# Autodesk Inventor assembly: MM0948AN140_G22_001
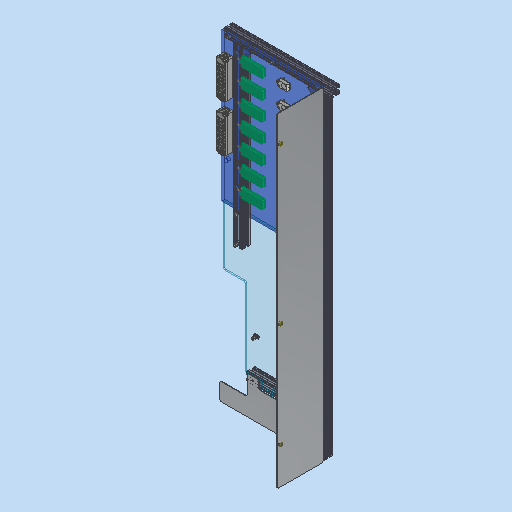
[picture p0: Inventor's stored thumbnail of the model, 512x512]
Saved by Autodesk Inventor 2023.3 (Build 273359000, 359)
## iProperties
Created: 2023-03-23
Part Number: MM0948AN140_G22_001
Description: =<RBPARTNOTITLE2>
Document SubType Name: Assembly
Designer: FH/Wi
Mass: 9319.01 g
Surface Area: 19971.7 cm^2
Volume: 3785.04 cm^3
Density: 2.46206 g/cm^3
AnP_Kategorie: 99
AnP_Material: =<Material>
AnP_TemplVers: 20200821
RBDOCUMENTTYPE: DRF
RBDOCUMENTVERSION: 00
RBDRAWINGMAINSCALE: 1:1
RBDRAWINGMISSINGSPEC: --
RBDRAWINGVOLUME: --
RBDSV1: 0850
RBGBEDGESIN1: +0,5
RBGBEDGESIN2: +0,2
RBGBEDGESOUT1: -0,3
RBGBEDGESOUT2: -0,1
RBMATERIAL: =<Material>
RBMATMEETS: --
RBMATNO: =<Part Number>
RBPARTMADEOF: --
RBPARTNO: SIEHE MNR
RBPARTNOTITLE1: protection XTS
RBPARTNOTITLE2: Eingriffschutz XTS
RBPARTSAFETYINDICATOR: --
RBSURFACE: --
RBSURFACE2: --
RBZEDGESNORM: ISO13715:2002-06
RBZGENDIMCLASS: m
RBZGENDIMNORM: ISO 2768-1:1989-11
RBZGENGEOCLASS: H
RBZGENGEONORM: ISO 2768-2:1989-11
RBZSURFACENORM: ISO13D2:2002-02
RBZTOLERANCENORM: ISO 14405-1:2010-12
Author: FH/Wi
Keywords: =<RBPARTMADEOF>
Comments: =<RBSURFACE2>
Revision Number: 01
## Documents named in this file (25)
- C:\Users\rea9an\Documents\Inventor\TCAI2412_te1910_EM\AS00000959.iam
- C:\Users\rea9an\Documents\Inventor\TCAI2412_te1910_EM\PT00004671.ipt
- C:\Users\rea9an\Documents\Inventor\TCAI2412_te1910_EM\PT00004404.ipt
- C:\Users\rea9an\Documents\Inventor\TCAI2412_te1910_EM\PT00004672.ipt
- C:\Users\rea9an\Documents\Inventor\TCAI2412_te1910_EM\PT00004327.ipt
- C:\Users\rea9an\Documents\Inventor\TCAI2412_te1910_EM\PT00004867.ipt
- C:\Users\rea9an\Documents\Inventor\TCAI2412_te1910_EM\PT00004683.ipt
- C:\Users\rea9an\Documents\Inventor\TCAI2412_te1910_EM\PT00004684.ipt
- C:\Users\rea9an\Documents\Inventor\TCAI2412_te1910_EM\PT00004924.ipt
- C:\Users\rea9an\Documents\Inventor\TCAI2412_te1910_EM\PT00004885.ipt
- C:\Users\rea9an\Documents\Inventor\TCAI2412_te1910_EM\PT00004887.ipt
- C:\Users\rea9an\Documents\Inventor\TCAI2412_te1910_EM\PT00004328.ipt
- C:\Users\rea9an\Documents\Inventor\TCAI2412_te1910_EM\PT00004401.ipt
- C:\Users\rea9an\Documents\Inventor\TCAI2412_te1910_EM\PT00004662.ipt
- C:\Users\rea9an\Documents\Inventor\TCAI2412_te1910_EM\PT00004294.ipt
- C:\Users\rea9an\Documents\Inventor\TCAI2412_te1910_EM\PT00004875.ipt
- C:\Users\rea9an\Documents\Inventor\TCAI2412_te1910_EM\PT00004298.ipt
- C:\Users\rea9an\Documents\Inventor\TCAI2412_te1910_EM\PT00004291.ipt
- C:\Users\rea9an\Documents\Inventor\TCAI2412_te1910_EM\PT00004886.ipt
- C:\Users\rea9an\Documents\Inventor\TCAI2412_te1910_EM\PT00004366.ipt
- C:\Users\rea9an\Documents\Inventor\TCAI2412_te1910_EM\PT00004859.ipt
- C:\Users\rea9an\Documents\Inventor\TCAI2412_te1910_EM\PT00004679.ipt
- C:\Users\rea9an\Documents\Inventor\TCAI2412_te1910_EM\PT00004716.ipt
- C:\Users\rea9an\Documents\Inventor\TCAI2412_te1910_EM\PT00004785.ipt
- C:\Users\rea9an\Documents\Inventor\TCAI2412_te1910_EM\PT00004783.ipt
## Components (102 placed, 24 different names)
1. PT00004671:1 — Passend:25, Einfügen:45, Einfügen:52, Einfügen:53, Einfügen:54, Einfügen:55, Einfügen:56, Fluchtend:30
2. PT00004672:1 — Passend:25, Einfügen:25, Einfügen:26, Einfügen:27, Einfügen:28, Einfügen:29, Einfügen:30, Einfügen:36, Einfügen:37, Einfügen:57, Passend:59, Passend:60, Einfügen:58, Passend:62, Einfügen:59, Passend:63, Fluchtend:29, Fluchtend:30, Einfügen:60
3. PT00004684:1 — Einfügen:31, Passend:52
4. PT00004683:1 — Passend:31, Einfügen:32, Passend:47, Fluchtend:24, Passend:50, Passend:54, Passend:56, Passend:64, Fluchtend:31, Fluchtend:34
5. PT00004366:1 — Passend:60, Einfügen:59, Passend:63
6. PT00004366:2 — Einfügen:58, Passend:62
7. PT00004885:8 — Einfügen:60
8. PT00004679:1 — Passend:64, Fluchtend:31, Fluchtend:32
9. PT00004716:1 — Passend:65, Fluchtend:34, Fluchtend:35, Passend:66, Passend:67, Passend:68, Passend:69, Passend:70, Passend:71, Passend:72, Passend:74, Passend:77, Passend:78, Passend:79, Passend:80
10. PT00004291:10
11. PT00004886:7 — Einfügen:62, Passend:66
12. PT00004785:1 — Einfügen:62, Passend:69
13. PT00004291:11
14. PT00004886:8 — Passend:67
15. PT00004785:2 — Passend:70
16. PT00004291:12
17. PT00004886:9 — Passend:68
18. PT00004785:3 — Passend:71
19. PT00004294:4 — Passend:73, Einfügen:68
20. PT00004875:4 — Passend:72, Passend:73, Einfügen:67, Einfügen:68
21. PT00004783:1 — Einfügen:67, Passend:74
22. PT00004294:5
23. PT00004875:5 — Passend:78
24. PT00004783:2 — Passend:79
25. PT00004294:6
26. PT00004875:6 — Passend:77
27. PT00004783:3 — Passend:80
28. PT00004291:4 — Einfügen:46
29. PT00004291:5
30. PT00004291:6
31. PT00004291:7
32. PT00004291:8
33. PT00004291:9
34. PT00004298:1 — Passend:49, Passend:50, Fluchtend:25, Fluchtend:26
35. PT00004298:2 — Passend:51, Passend:52, Fluchtend:26
36. PT00004298:3 — Passend:53, Passend:54, Fluchtend:28
37. PT00004298:4 — Passend:55, Fluchtend:27, Passend:56, Fluchtend:28
38. PT00004327:1 — Passend:31, Passend:49, Fluchtend:25, Passend:51, Fluchtend:29, Passend:65, Fluchtend:35
39. PT00004328:1 — Passend:47, Fluchtend:24, Passend:48, Passend:53, Passend:55, Fluchtend:27, Fluchtend:32
40. PT00004886:1 — Einfügen:45, Einfügen:46
41. PT00004886:2 — Einfügen:56
42. PT00004886:3 — Einfügen:55
43. PT00004886:4 — Einfügen:52
44. PT00004886:5 — Einfügen:53
45. PT00004886:6 — Einfügen:54
46. PT00004924:1 — Einfügen:26
47. PT00004924:2 — Einfügen:25
48. PT00004885:1 — Einfügen:27
49. PT00004885:2 — Einfügen:28
50. PT00004885:3 — Einfügen:30
51. PT00004885:4 — Einfügen:29
52. PT00004887:1 — Einfügen:32
53. PT00004887:2 — Einfügen:31
54. PT00004859:1 — Einfügen:40
55. PT00004401:1 — Einfügen:38, Einfügen:39, Einfügen:40, Einfügen:41
56. PT00004662:1 — Einfügen:36, Einfügen:37, Einfügen:38, Einfügen:39
57. PT00004859:8 — Einfügen:41
58. PT00004859:2
59. PT00004401:2
60. PT00004662:2
61. PT00004859:9
62. PT00004859:3
63. PT00004401:3
64. PT00004662:3
65. PT00004859:10
66. PT00004859:4
67. PT00004401:4
68. PT00004662:4
69. PT00004859:11
70. PT00004859:5
71. PT00004401:5
72. PT00004662:5
73. PT00004859:12
74. PT00004859:6
75. PT00004401:6
76. PT00004662:6
77. PT00004859:13
78. PT00004859:7
79. PT00004401:7
80. PT00004662:7
81. PT00004859:14
82. PT00004404:1 — Einfügen:23, Einfügen:24, Einfügen:57, Passend:59
83. PT00004867:2 — Einfügen:23
84. PT00004867:1 — Einfügen:24
85. PT00004404:2
86. PT00004867:3
87. PT00004867:4
88. PT00004404:3
89. PT00004867:5
90. PT00004867:6
91. PT00004404:4
92. PT00004867:7
93. PT00004867:8
94. PT00004404:5
95. PT00004867:9
96. PT00004867:10
97. PT00004404:6
98. PT00004867:11
99. PT00004867:12
100. PT00004404:7
101. PT00004867:13
102. PT00004867:14
## Component patterns: (7 elements, first: PT00004859:1 + PT00004401:1 + PT00004662:1 + PT00004859:8), (7 elements, first: PT00004404:1 + PT00004867:2 + PT00004867:1)
## Relationships (98: Insert 44, Mate 37, Flush 17)
- [Flush]: PT00004672:1 ↔ PT00004327:1
- [Mate]: PT00004684:1 ↔ PT00004327:1
- [Flush]: PT00004684:1 ↔ PT00004327:1
- [Flush] (31 mm): PT00004684:1 ↔ PT00004327:1
- [Flush]: PT00004683:1 ↔ PT00004327:1
- [Mate] (-315 mm): PT00004327:1
- [Flush] (1464 mm): PT00004327:1
- [Flush] (-1138 mm): PT00004327:1
- [Mate]: PT00004672:1 ↔ PT00004327:1
- [Mate]: PT00004671:1 ↔ PT00004683:1
- Passend:25 [Mate]: PT00004671:1 ↔ PT00004672:1
- Passend:31 [Mate]: PT00004683:1 ↔ PT00004327:1
- Einfügen:23 [Insert]: PT00004404:1 ↔ PT00004867:2
- Einfügen:24 [Insert]: PT00004404:1 ↔ PT00004867:1
- Einfügen:25 [Insert]: PT00004672:1 ↔ PT00004924:2
- Einfügen:26 [Insert]: PT00004672:1 ↔ PT00004924:1
- Einfügen:27 [Insert]: PT00004672:1 ↔ PT00004885:1
- Einfügen:28 [Insert]: PT00004672:1 ↔ PT00004885:2
- Einfügen:29 [Insert]: PT00004672:1 ↔ PT00004885:4
- Einfügen:30 [Insert]: PT00004672:1 ↔ PT00004885:3
- Einfügen:31 [Insert]: PT00004684:1 ↔ PT00004887:2
- Einfügen:32 [Insert]: PT00004683:1 ↔ PT00004887:1
- Passend:47 [Mate]: PT00004683:1 ↔ PT00004328:1
- Fluchtend:24 [Flush]: PT00004683:1 ↔ PT00004328:1
- Passend:48 [Mate] (140 mm): PT00004328:1
- Einfügen:36 [Insert]: PT00004672:1 ↔ PT00004662:1
- Einfügen:37 [Insert]: PT00004672:1 ↔ PT00004662:1
- Einfügen:38 [Insert]: PT00004401:1 ↔ PT00004662:1
- Einfügen:39 [Insert]: PT00004401:1 ↔ PT00004662:1
- Einfügen:40 [Insert]: PT00004859:1 ↔ PT00004401:1
- Einfügen:41 [Insert]: PT00004401:1 ↔ PT00004859:8
- Passend:49 [Mate]: PT00004298:1 ↔ PT00004327:1
- Passend:50 [Mate]: PT00004683:1 ↔ PT00004298:1
- Fluchtend:25 [Flush] (1 mm): PT00004298:1 ↔ PT00004327:1
- Passend:51 [Mate]: PT00004298:2 ↔ PT00004327:1
- Passend:52 [Mate]: PT00004684:1 ↔ PT00004298:2
- Fluchtend:26 [Flush]: PT00004298:1 ↔ PT00004298:2
- Passend:53 [Mate]: PT00004298:3 ↔ PT00004328:1
- Passend:54 [Mate]: PT00004683:1 ↔ PT00004298:3
- Passend:55 [Mate]: PT00004298:4 ↔ PT00004328:1
- Fluchtend:27 [Flush] (1 mm): PT00004298:4 ↔ PT00004328:1
- Passend:56 [Mate]: PT00004683:1 ↔ PT00004298:4
- Fluchtend:28 [Flush]: PT00004298:3 ↔ PT00004298:4
- Einfügen:45 [Insert]: PT00004671:1 ↔ PT00004886:1
- Einfügen:46 [Insert] (5.5 mm): PT00004291:4 ↔ PT00004886:1
- [Insert] (5.5 mm): PT00004291:5 ↔ PT00004886:2
- [Insert] (5.5 mm): PT00004291:6 ↔ PT00004886:3
- [Insert] (5.5 mm): PT00004291:7 ↔ PT00004886:4
- [Insert] (5.5 mm): PT00004291:8 ↔ PT00004886:5
- [Insert] (5.5 mm): PT00004291:9 ↔ PT00004886:6
- Einfügen:52 [Insert]: PT00004671:1 ↔ PT00004886:4
- Einfügen:53 [Insert]: PT00004671:1 ↔ PT00004886:5
- Einfügen:54 [Insert]: PT00004671:1 ↔ PT00004886:6
- Einfügen:55 [Insert]: PT00004671:1 ↔ PT00004886:3
- Einfügen:56 [Insert]: PT00004671:1 ↔ PT00004886:2
- Einfügen:57 [Insert]: PT00004672:1 ↔ PT00004404:1
- Passend:59 [Mate]: PT00004672:1 ↔ PT00004404:1
- Passend:60 [Mate]: PT00004672:1 ↔ PT00004366:1
- Einfügen:58 [Insert]: PT00004672:1 ↔ PT00004366:2
- Passend:62 [Mate]: PT00004672:1 ↔ PT00004366:2
- Einfügen:59 [Insert]: PT00004672:1 ↔ PT00004366:1
- Passend:63 [Mate]: PT00004672:1 ↔ PT00004366:1
- Fluchtend:29 [Flush] (-2 mm): PT00004672:1 ↔ PT00004327:1
- Fluchtend:30 [Flush]: PT00004671:1 ↔ PT00004672:1
- Einfügen:60 [Insert]: PT00004672:1 ↔ PT00004885:8
- Passend:64 [Mate]: PT00004683:1 ↔ PT00004679:1
- Fluchtend:31 [Flush] (2 mm): PT00004683:1 ↔ PT00004679:1
- Fluchtend:32 [Flush] (2 mm): PT00004679:1 ↔ PT00004328:1
- Passend:65 [Mate]: PT00004716:1 ↔ PT00004327:1
- Fluchtend:34 [Flush] (-4 mm): PT00004683:1 ↔ PT00004716:1
- Fluchtend:35 [Flush] (2 mm): PT00004716:1 ↔ PT00004327:1
- [Insert] (5.5 mm): PT00004291:10 ↔ PT00004886:7
- Einfügen:62 [Insert]: PT00004886:7 ↔ PT00004785:1
- [Insert] (5.5 mm): PT00004291:11 ↔ PT00004886:8
- [Insert]: PT00004886:8 ↔ PT00004785:2
- [Insert] (5.5 mm): PT00004291:12 ↔ PT00004886:9
- [Insert]: PT00004886:9 ↔ PT00004785:3
- Passend:66 [Mate]: PT00004716:1 ↔ PT00004886:7
- Passend:67 [Mate]: PT00004716:1 ↔ PT00004886:8
- Passend:68 [Mate]: PT00004716:1 ↔ PT00004886:9
- Passend:69 [Mate]: PT00004716:1 ↔ PT00004785:1
- Passend:70 [Mate]: PT00004716:1 ↔ PT00004785:2
- Passend:71 [Mate]: PT00004716:1 ↔ PT00004785:3
- Passend:72 [Mate]: PT00004716:1 ↔ PT00004875:4
- Passend:73 [Mate]: PT00004294:4 ↔ PT00004875:4
- Einfügen:67 [Insert]: PT00004875:4 ↔ PT00004783:1
- Passend:74 [Mate]: PT00004716:1 ↔ PT00004783:1
- Einfügen:68 [Insert] (-4 mm): PT00004294:4 ↔ PT00004875:4
- [Mate]: PT00004294:5 ↔ PT00004875:5
- [Insert]: PT00004875:5 ↔ PT00004783:2
- [Insert] (-4 mm): PT00004294:5 ↔ PT00004875:5
- [Mate]: PT00004294:6 ↔ PT00004875:6
- [Insert]: PT00004875:6 ↔ PT00004783:3
- [Insert] (-4 mm): PT00004294:6 ↔ PT00004875:6
- Passend:77 [Mate]: PT00004716:1 ↔ PT00004875:6
- Passend:78 [Mate]: PT00004716:1 ↔ PT00004875:5
- Passend:79 [Mate]: PT00004716:1 ↔ PT00004783:2
- Passend:80 [Mate]: PT00004716:1 ↔ PT00004783:3
## Named parameters: d154_d153 = 5.5 mm, d155_d153 = 5.5 mm, d156_d153 = 5.5 mm, d157_d153 = 5.5 mm, d158_d153 = 5.5 mm, d190_d155_d153 = 5.5 mm, d192_d190_d155_d153 = 5.5 mm, d193_d191 = 0 mm, d194_d190_d155_d153 = 5.5 mm, d195_d191 = 0 mm, d207_d203 = 0 mm, d208_d204 = 0 mm, d209_d206 = -4 mm, d210_d203 = 0 mm, d211_d204 = 0 mm, d212_d206 = -4 mm
